# Autodesk Inventor assembly: rodizio robo real
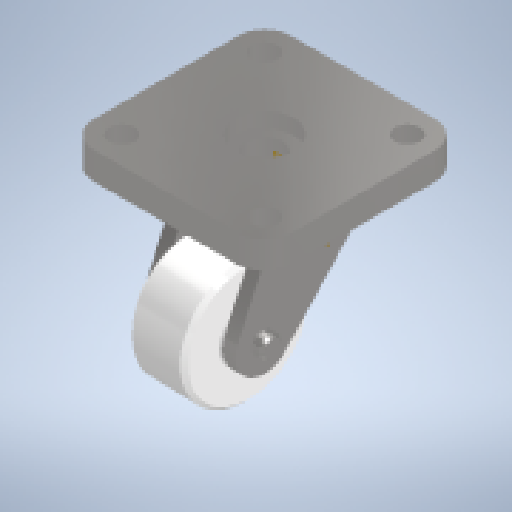
[picture p0: Inventor's stored thumbnail of the model, 512x512]
Saved by Autodesk Inventor 2025.1 (Build 291241020, 241B)
## iProperties
Created: 2023-06-25
Part Number: rodizio robo real
Document SubType Name: Assembly
Designer: Jeroen
Author: Jeroen
## Documents named in this file (5)
- C:\Users\Alecs\OneDrive\Área de Trabalho\Robo Real Rev 2 08-11\rodizio robo real.iam
- C:\Users\Alecs\OneDrive\Área de Trabalho\Robo Real Rev 2 08-11\VTK_02.02-Zwenkwiel-Bevestigingsplaat.ipt
- C:\Users\Alecs\OneDrive\Área de Trabalho\Robo Real Rev 2 08-11\VTK_02.02-Zwenkwiel-Beugel.ipt
- C:\Users\Alecs\OneDrive\Área de Trabalho\Robo Real Rev 2 08-11\VTK_02.02-Zwenkwiel-Wiel.ipt
- C:\Users\Alecs\OneDrive\Área de Trabalho\Robo Real Rev 2 08-11\VTK_02.02-Zwenkwiel-As.ipt
## Components (4 placed, 4 different names)
1. VTK_02.02-Zwenkwiel-Bevestigingsplaat:1 — Coincidente:1, Coincidente:2
2. VTK_02.02-Zwenkwiel-Beugel:1 — Inserir:3, Inserir:6, Coincidente:1, Coincidente:2
3. VTK_02.02-Zwenkwiel-Wiel:1 — Inserir:6
4. VTK_02.02-Zwenkwiel-As:1 — Inserir:3
## Relationships (4: Insert 2, Mate 2)
- Inserir:3 (0.5 mm): VTK_02.02-Zwenkwiel-Beugel:1 ↔ VTK_02.02-Zwenkwiel-As:1
- Inserir:6: VTK_02.02-Zwenkwiel-Beugel:1 ↔ VTK_02.02-Zwenkwiel-Wiel:1
- Coincidente:1 [Mate]: VTK_02.02-Zwenkwiel-Bevestigingsplaat:1 ↔ VTK_02.02-Zwenkwiel-Beugel:1
- Coincidente:2 [Mate]: VTK_02.02-Zwenkwiel-Bevestigingsplaat:1 ↔ VTK_02.02-Zwenkwiel-Beugel:1
